# Autodesk Inventor assembly: 6_07_asm_detection2
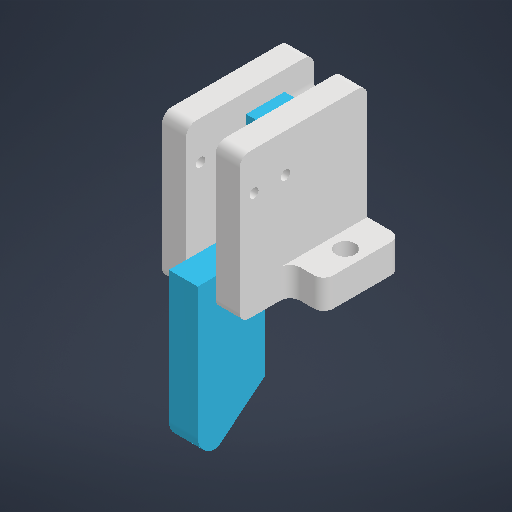
[picture p0: Inventor's stored thumbnail of the model, 512x512]
Saved by Autodesk Inventor 2026 (Build 300175000, 175)
## iProperties
Created: 2025-06-18
Part Number: 6_07_asm_detection2
Document SubType Name: Assembly
Designer: Diogo
Author: Diogo
## Documents named in this file (3)
- C:\Users\Diogo\OneDrive - HESSO\P2511_Dossier_partage_RVEZ\01_Robot\0101_CAO\6_Detection\6_07_asm_detection2.iam
- C:\Users\Diogo\OneDrive - HESSO\P2511_Dossier_partage_RVEZ\01_Robot\0101_CAO\6_Detection\6_06_support_detection2.ipt
- C:\Users\Diogo\OneDrive - HESSO\P2511_Dossier_partage_RVEZ\01_Robot\0101_CAO\6_Detection\6_05_piece_mobile.ipt
## Components (2 placed, 2 different names)
1. 6_06_support_detection2:1 — Placage:1, Placage:2, Affleurement:1
2. 6_05_piece_mobile:1 — Placage:1, Placage:2, Affleurement:1
## Relationships (3: Mate 2, Flush 1)
- Placage:1 [Mate]: 6_06_support_detection2:1 ↔ 6_05_piece_mobile:1
- Placage:2 [Mate]: 6_06_support_detection2:1 ↔ 6_05_piece_mobile:1
- Affleurement:1 [Flush]: 6_06_support_detection2:1 ↔ 6_05_piece_mobile:1
## Named parameters: Finish1_Area = 20.7798, Finish1_Thickness = 0.05 mm
note: some values were not read from the file. Shown as the stored number, unit unknown: "Finish1_Area".
